# Autodesk Inventor assembly: Ensamble parcial
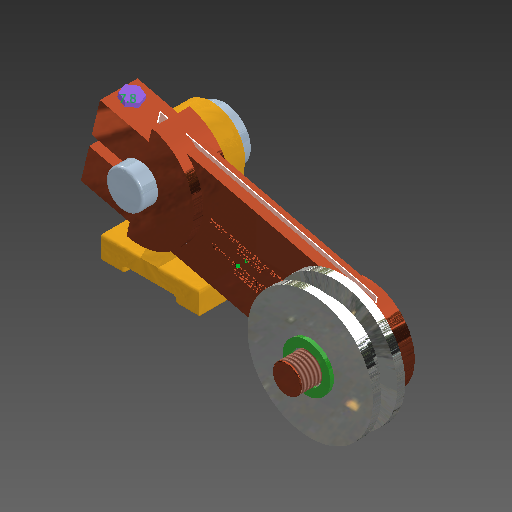
[picture p0: Inventor's stored thumbnail of the model, 512x512]
Saved by Autodesk Inventor 2026.1 (Build 301233020, 233B)
## iProperties
Created: 2026-10-30
Part Number: Ensamble parcial
Document SubType Name: Assembly
Designer: YmCris
Author: YmCris
## Documents named in this file (8)
- C:\Users\Fortune\Mechanical Engenieering\Fourth Semester\Mechanical Engineering Drawing\Inventor Projects\Segundo Parcial\Ensamble\Ensamble parcial.iam
- C:\Users\Fortune\Mechanical Engenieering\Fourth Semester\Mechanical Engineering Drawing\Inventor Projects\Segundo Parcial\Figuras (ipt)\PERNO 2 EXAMEN PARCIAL.ipt
- C:\Users\Fortune\Mechanical Engenieering\Fourth Semester\Mechanical Engineering Drawing\Inventor Projects\Segundo Parcial\Figuras (ipt)\Perno Examen.ipt
- C:\Users\Fortune\Mechanical Engenieering\Fourth Semester\Mechanical Engineering Drawing\Inventor Projects\Segundo Parcial\Figuras (ipt)\PIEZA FIJA EXAMEN PARCIAL.ipt
- C:\Users\Fortune\Mechanical Engenieering\Fourth Semester\Mechanical Engineering Drawing\Inventor Projects\Segundo Parcial\Figuras (ipt)\PIN 1 EXAMEN PARCIAL .ipt
- C:\Users\Fortune\Mechanical Engenieering\Fourth Semester\Mechanical Engineering Drawing\Inventor Projects\Segundo Parcial\Figuras (ipt)\Polea.ipt
- C:\Users\Fortune\Mechanical Engenieering\Fourth Semester\Mechanical Engineering Drawing\Inventor Projects\Segundo Parcial\Figuras (ipt)\RONDANA EXAMEN PARCIAL .ipt
- C:\Users\Fortune\Mechanical Engenieering\Fourth Semester\Mechanical Engineering Drawing\Inventor Projects\Segundo Parcial\Figuras (ipt)\Brazo.ipt
## Components (7 placed, 7 different names)
1. PERNO 2 EXAMEN PARCIAL:1 — Insert:3
2. Perno Examen:1 — Insert:5
3. PIEZA FIJA EXAMEN PARCIAL:1 — Insert:1
4. PIN 1 EXAMEN PARCIAL :1 — Insert:1, Insert:2
5. Polea:1 — Insert:4, Mate:1
6. RONDANA EXAMEN PARCIAL :1 — Mate:1
7. Brazo:1 — Insert:2, Insert:3, Insert:4, Insert:5
## Relationships (6: Insert 5, Mate 1)
- Insert:1: PIEZA FIJA EXAMEN PARCIAL:1 ↔ PIN 1 EXAMEN PARCIAL :1
- Insert:2 (-40 mm): PIN 1 EXAMEN PARCIAL :1 ↔ Brazo:1
- Insert:3: PERNO 2 EXAMEN PARCIAL:1 ↔ Brazo:1
- Insert:4: Polea:1 ↔ Brazo:1
- Mate:1: Polea:1 ↔ RONDANA EXAMEN PARCIAL :1
- Insert:5: Perno Examen:1 ↔ Brazo:1
